# Autodesk Inventor assembly: ASY DMF-4200 Drive Shaft
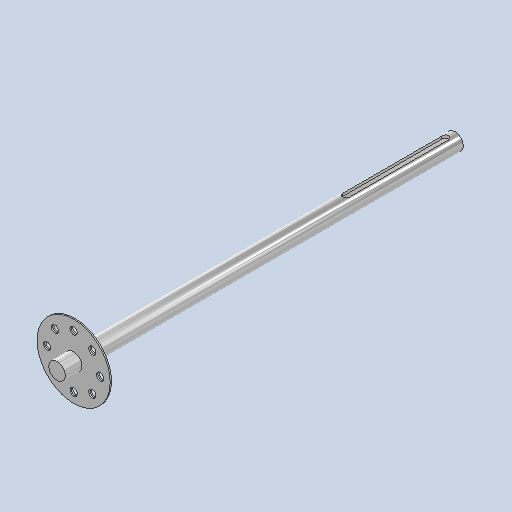
[picture p0: Inventor's stored thumbnail of the model, 512x512]
Saved by Autodesk Inventor 2026.2 (Build 302298000, 298)
## iProperties
Created: 2026-11-10
Part Number: ASY DMF-4200 Drive Shaft
Document SubType Name: Assembly
Designer: admin
Stock Number: DMF-4200
Author: admin
## Documents named in this file (4)
- C:\Users\admin\Documents\Inventor\DMF-Disk-Micro-Filter\ASY DMF-4200 Drive Shaft.iam
- C:\Users\admin\Documents\Inventor\DMF-Disk-Micro-Filter\DMF-4003 Drive Shaft.ipt
- C:\Users\admin\Documents\Inventor\DMF-Disk-Micro-Filter\Барабан v2.1\DMF-4002 Small Gear Flange 01.ipt
- C:\Users\admin\Documents\Inventor\DMF-Disk-Micro-Filter\Барабан v2.1\DMF-4007 Small Gear Flange 02.ipt
## Components (3 placed, 3 different names)
1. DMF-4003 Drive Shaft:1
2. DMF-4002 Small Gear Flange 01:1
3. DMF-4007 Small Gear Flange 02:1
## Relationships (2: WeldJoint 2)
- [WeldJoint]: DMF-4002 Small Gear Flange 01:1 ↔ DMF-4007 Small Gear Flange 02:1
- [WeldJoint] (-25 mm): DMF-4003 Drive Shaft:1 ↔ DMF-4002 Small Gear Flange 01:1
